# Autodesk Inventor assembly: V6_Block_Assembly
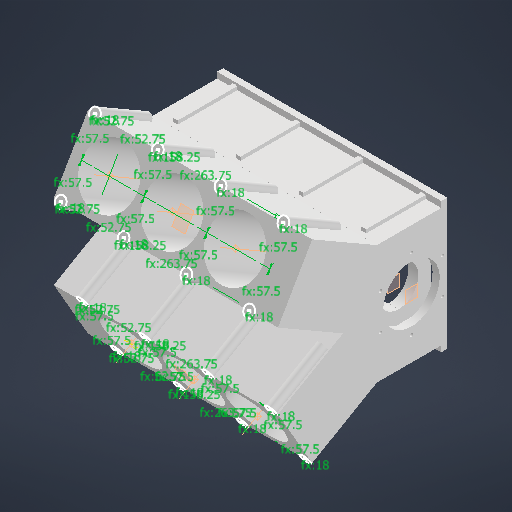
[picture p0: Inventor's stored thumbnail of the model, 512x512]
Saved by Autodesk Inventor 2027.1 (Build 311270010, 270A)
## iProperties
Created: 2026-10-17
Part Number: V6_Block_Assembly
Document SubType Name: Assembly
Designer: kashyap
Author: kashyap
## Documents named in this file (3)
- C:\Users\kashyap\Documents\V6_2GR\V6_Block_Assembly.iam
- C:\Users\kashyap\Documents\V6_2GR\V6_Engine_Block.ipt
- C:\Users\kashyap\Documents\V6_2GR\V6_Main_Bearing_Cap.ipt
## Components (5 placed, 2 different names)
1. V6_Engine_Block:1 — Cap1_X_Station, Cap1_Split_Line, Cap1_Centre, Cap2_X_Station, Cap2_Split_Line, Cap2_Centre, Cap3_X_Station, Cap3_Split_Line, Cap3_Centre, Cap4_X_Station, Cap4_Split_Line, Cap4_Centre
2. V6_Main_Bearing_Cap:1 — Cap1_X_Station, Cap1_Split_Line, Cap1_Centre
3. V6_Main_Bearing_Cap:2 — Cap2_X_Station, Cap2_Split_Line, Cap2_Centre
4. V6_Main_Bearing_Cap:3 — Cap3_X_Station, Cap3_Split_Line, Cap3_Centre
5. V6_Main_Bearing_Cap:4 — Cap4_X_Station, Cap4_Split_Line, Cap4_Centre
## Relationships (12: Flush 12)
- Cap1_X_Station [Flush]: V6_Engine_Block:1 ↔ V6_Main_Bearing_Cap:1
- Cap1_Split_Line [Flush]: V6_Engine_Block:1 ↔ V6_Main_Bearing_Cap:1
- Cap1_Centre [Flush]: V6_Engine_Block:1 ↔ V6_Main_Bearing_Cap:1
- Cap2_X_Station [Flush]: V6_Engine_Block:1 ↔ V6_Main_Bearing_Cap:2
- Cap2_Split_Line [Flush]: V6_Engine_Block:1 ↔ V6_Main_Bearing_Cap:2
- Cap2_Centre [Flush]: V6_Engine_Block:1 ↔ V6_Main_Bearing_Cap:2
- Cap3_X_Station [Flush]: V6_Engine_Block:1 ↔ V6_Main_Bearing_Cap:3
- Cap3_Split_Line [Flush]: V6_Engine_Block:1 ↔ V6_Main_Bearing_Cap:3
- Cap3_Centre [Flush]: V6_Engine_Block:1 ↔ V6_Main_Bearing_Cap:3
- Cap4_X_Station [Flush]: V6_Engine_Block:1 ↔ V6_Main_Bearing_Cap:4
- Cap4_Split_Line [Flush]: V6_Engine_Block:1 ↔ V6_Main_Bearing_Cap:4
- Cap4_Centre [Flush]: V6_Engine_Block:1 ↔ V6_Main_Bearing_Cap:4
